# Autodesk Inventor assembly: 6357-3 FP-276x1196x47
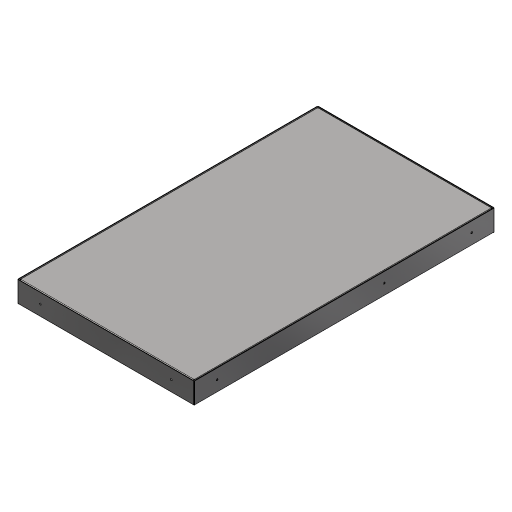
[picture p0: Inventor's stored thumbnail of the model, 512x512]
Saved by Autodesk Inventor 2024.3 (Build 283343000, 343)
## iProperties
Created: 2019-06-26
Part Number: 6357-3 FP-276x1196x47
Material: Generisch
Document SubType Name: Assembly
Designer: MK
Mass: 5333.12 g
Surface Area: 13647.6 cm^2
Volume: 679.378 cm^3
Density: 7.85 g/cm^3
Description: Festes-Paneel
Author: MK
## Documents named in this file (3)
- C:\Users\la\Documents\GitHub\Inventor_Sizer\C# Version\masters\FP\1T\6357-3 FP-276x1196x47.iam
- C:\Users\la\Documents\GitHub\Inventor_Sizer\C# Version\masters\FP\1T\6357-3 276x1196x47-Au.ipt
- C:\Users\la\Documents\GitHub\Inventor_Sizer\C# Version\masters\FP\1T\6357-3 276x1196x47-In.ipt
## Components (2 placed, 2 different names)
1. 6357-3 276x1196x47-Au:1 — Passend:1, Fluchtend:1, Passend:2
2. 6357-3 276x1196x47-In:1 — Passend:1, Fluchtend:1, Passend:2
## Relationships (3: Mate 2, Flush 1)
- Passend:1 [Mate] (0.5 mm): 6357-3 276x1196x47-Au:1 ↔ 6357-3 276x1196x47-In:1
- Fluchtend:1 [Flush]: 6357-3 276x1196x47-Au:1 ↔ 6357-3 276x1196x47-In:1
- Passend:2 [Mate] (0.5 mm): 6357-3 276x1196x47-Au:1 ↔ 6357-3 276x1196x47-In:1
## Named parameters: Clearance = 0.5 mm
